# Autodesk Inventor assembly: Ensamble
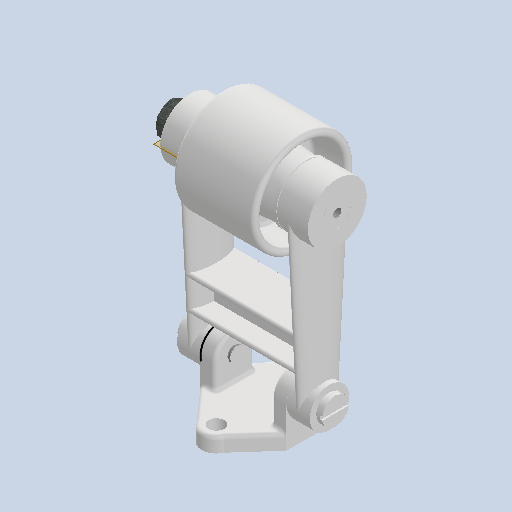
[picture p0: Inventor's stored thumbnail of the model, 512x512]
Saved by Autodesk Inventor 2025.3 (Build 293356030, 356C)
## iProperties
Created: 2025-08-17
Part Number: Ensamble
Document SubType Name: Assembly
Designer: PC
Author: PC
## Documents named in this file (11)
- C:\Users\PC\Desktop\Ensamble DMW 2025\Ensamble.iam
- C:\Users\PC\Desktop\Ensamble DMW 2025\Arandela d48.ipt
- C:\Users\PC\Desktop\Ensamble DMW 2025\Arandela d50.ipt
- C:\Users\PC\Desktop\Ensamble DMW 2025\Buje.ipt
- C:\Users\PC\Desktop\Ensamble DMW 2025\Eje de acero.ipt
- C:\Users\PC\Desktop\Ensamble DMW 2025\Marco.ipt
- C:\Users\PC\Desktop\Ensamble DMW 2025\Pasador de acero.ipt
- C:\Users\PC\Desktop\Ensamble DMW 2025\Polea.ipt
- C:\Users\PC\Desktop\Ensamble DMW 2025\Soporte.ipt
- C:\Users\PC\Documents\Inventor\Content Center Files\R2025\en-US\ANSI B17.2(2)\ANSI B17.2 - No. 406.ipt
- C:\Users\PC\Documents\Inventor\Content Center Files\R2025\en-US\ISO 4034(2)\ISO 4034 - M16 - ISO.ipt
## Components (11 placed, 10 different names)
1. Arandela d48:1 — Mate:8, Mate:9
2. Arandela d50:1 — Mate:10, Mate:11
3. Buje:1 — Mate:12, Flush:3
4. Eje de acero:1 — Mate:4, Mate:5, Mate:6, Mate:8, Mate:10, Mate:12, Mate:13
5. Marco:1 — Mate:2, Mate:3, Mate:4, Mate:5, Insert:1, Insert:2, Mate:14
6. Pasador de acero:1 — Insert:2
7. Polea:1 — Mate:6, Mate:7, Mate:9, Mate:11
8. Soporte:1 — Flush:1, Flush:2, Mate:1, Mate:2
9. Pasador de acero:2 — Insert:1
10. Full Radius No. 406:1
11. ISO 4034 M16:1 — Mate:13, Mate:14
## Relationships (19: Mate 14, Flush 3, Insert 2)
- Flush:1: Soporte:1
- Flush:2: Soporte:1
- Mate:1: Soporte:1
- Mate:2: Marco:1 ↔ Soporte:1
- Mate:3: Marco:1
- Mate:4: Eje de acero:1 ↔ Marco:1
- Mate:5: Eje de acero:1 ↔ Marco:1
- Mate:6: Eje de acero:1 ↔ Polea:1
- Mate:7: Polea:1
- Mate:8: Arandela d48:1 ↔ Eje de acero:1
- Mate:9: Arandela d48:1 ↔ Polea:1
- Mate:10: Arandela d50:1 ↔ Eje de acero:1
- Mate:11: Arandela d50:1 ↔ Polea:1
- Mate:12: Buje:1 ↔ Eje de acero:1
- Flush:3: Buje:1
- Insert:1: Marco:1 ↔ Pasador de acero:2
- Insert:2: Marco:1 ↔ Pasador de acero:1
- Mate:13: Eje de acero:1 ↔ ISO 4034 M16:1
- Mate:14: Marco:1 ↔ ISO 4034 M16:1
